# Autodesk Inventor assembly: Membrane-welded
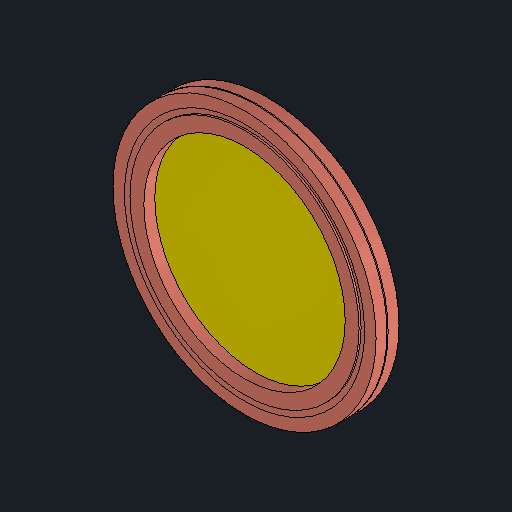
[picture p0: Inventor's stored thumbnail of the model, 512x512]
Saved by Autodesk Inventor 2027.1 (Build 311270010, 270A)
## iProperties
Created: 2019-10-17
Part Number: Membrane-welded
Document SubType Name: Assembly
Designer: kuzmin
Mass: 28.706 g
Surface Area: 66.037 cm^2
Volume: 3.14588 cm^3
Density: 9.12496 g/cm^3
Author: kuzmin
## Documents named in this file (3)
- C:\Users\queezz\Dropbox\Drawings\pihti-cad\Miura-membrane-experiments\Membrane-welded.iam
- C:\Users\queezz\Dropbox\Drawings\pihti-cad\Miura-membrane-experiments\membrane.ipt
- C:\Users\queezz\Dropbox\Drawings\pihti-cad\Miura-membrane-experiments\components\Gasket_70.ipt
## Components (3 placed, 2 different names)
1. membrane:1 — Mate:1, Mate:2, Mate:3, Mate:4, Mate:5, Flush:1, Flush:2
2. Gasket_70:1 — Mate:2, Mate:4
3. Gasket_70:2 — Mate:1, Mate:3
## Relationships (7: Mate 5, Flush 2)
- Mate:1: membrane:1 ↔ Gasket_70:2
- Mate:2: membrane:1 ↔ Gasket_70:1
- Mate:3: membrane:1 ↔ Gasket_70:2
- Mate:4: membrane:1 ↔ Gasket_70:1
- Mate:5: membrane:1
- Flush:1: membrane:1
- Flush:2: membrane:1
